# Autodesk Inventor assembly: robot_complet_1
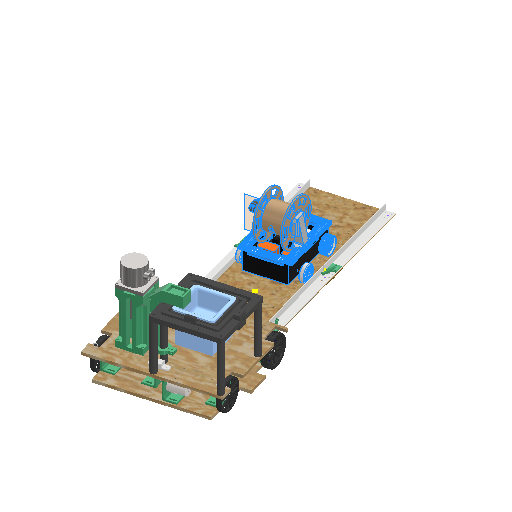
[picture p0: Inventor's stored thumbnail of the model, 512x512]
Saved by Autodesk Inventor 2026 (Build 300175000, 175)
## iProperties
Created: 2025-05-12
Part Number: robot_complet_1
Document SubType Name: Assembly
Designer: karle
Author: karle
## Documents named in this file (3)
- C:\Users\remg9\OneDrive - HESSO\P2511_Dossier_partage_RVEZ\01_Robot\0101_CAO\robot_complet_1.iam
- C:\Users\remg9\OneDrive - HESSO\P2511_Dossier_partage_RVEZ\01_Robot\0101_CAO\ASM_petit_Robot.iam
- C:\Users\remg9\OneDrive - HESSO\P2511_Dossier_partage_RVEZ\01_Robot\0101_CAO\ASM_grand_Robot_3.iam
## Components (2 placed, 2 different names)
1. ASM_petit_Robot:1 [sub-assembly] — Mate:3, Flush:1, Mate:4, Mate:5
2. ASM_grand_Robot_3:1 [sub-assembly] — Mate:3, Flush:1, Mate:4, Mate:5, Mate:6
## Relationships (5: Mate 4, Flush 1)
- Mate:3 (25 mm): ASM_petit_Robot:1 ↔ ASM_grand_Robot_3:1
- Flush:1 (-400 mm): ASM_petit_Robot:1 ↔ ASM_grand_Robot_3:1
- Mate:4 (10 mm): ASM_petit_Robot:1 ↔ ASM_grand_Robot_3:1
- Mate:5: ASM_petit_Robot:1 ↔ ASM_grand_Robot_3:1
- Mate:6: ASM_grand_Robot_3:1
